# Autodesk Inventor assembly: dulap_suspendat
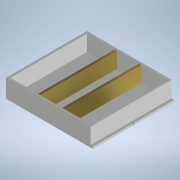
[picture p0: Inventor's stored thumbnail of the model, 180x180]
Saved by Autodesk Inventor 2022.6 (Build 266554000, 554)
## iProperties
Created: 2025-08-04
Part Number: dulap_suspendat
Document SubType Name: Assembly
Designer: Dragos Macovei
Author: Dragos Macovei
## Documents named in this file (5)
- C:\Users\Dragos Macovei\Documents\Inventor_3d_parts\Tancabesti_comanda_pal\dulap_suspendat.iam
- C:\Users\Dragos Macovei\Documents\Inventor_3d_parts\Tancabesti_comanda_pal\polita_dulap_deasupra_chiuveta.ipt
- C:\Users\Dragos Macovei\Documents\Inventor_3d_parts\Tancabesti_comanda_pal\capac-dulap_deasupra_chiuveta.ipt
- C:\Users\Dragos Macovei\Documents\Inventor_3d_parts\Tancabesti_comanda_pal\perete_lateral_dulap-suspendat.ipt
- C:\Users\Dragos Macovei\Documents\Inventor_3d_parts\Tancabesti_comanda_pal\usa dulap_suspendat_sus.ipt
## Components (8 placed, 4 different names)
1. polita_dulap_deasupra_chiuveta:2 — Mate:5, Flush:8
2. polita_dulap_deasupra_chiuveta:3 — Mate:4, Flush:7
3. capac-dulap_deasupra_chiuveta:1 — Mate:3, Flush:5, Flush:6, Flush:9, Flush:11
4. capac-dulap_deasupra_chiuveta:2 — Mate:1, Mate:2, Flush:3, Flush:4
5. perete_lateral_dulap-suspendat:1 — Flush:1, Flush:2, Mate:2, Flush:3, Mate:7, Flush:10
6. perete_lateral_dulap-suspendat:2 — Flush:1, Flush:2, Mate:1, Flush:4, Mate:3, Flush:5, Flush:6, Mate:4, Flush:7, Mate:5, Flush:8, Mate:6, Flush:12
7. usa dulap_suspendat_sus:1 — Mate:6, Flush:11, Flush:12
8. usa dulap_suspendat_sus:2 — Mate:7, Flush:9, Flush:10
## Relationships (19: Flush 12, Mate 7)
- Flush:1: perete_lateral_dulap-suspendat:1 ↔ perete_lateral_dulap-suspendat:2
- Flush:2: perete_lateral_dulap-suspendat:1 ↔ perete_lateral_dulap-suspendat:2
- Mate:1: capac-dulap_deasupra_chiuveta:2 ↔ perete_lateral_dulap-suspendat:2
- Mate:2: capac-dulap_deasupra_chiuveta:2 ↔ perete_lateral_dulap-suspendat:1
- Flush:3: capac-dulap_deasupra_chiuveta:2 ↔ perete_lateral_dulap-suspendat:1
- Flush:4: capac-dulap_deasupra_chiuveta:2 ↔ perete_lateral_dulap-suspendat:2
- Mate:3: capac-dulap_deasupra_chiuveta:1 ↔ perete_lateral_dulap-suspendat:2
- Flush:5: capac-dulap_deasupra_chiuveta:1 ↔ perete_lateral_dulap-suspendat:2
- Flush:6: capac-dulap_deasupra_chiuveta:1 ↔ perete_lateral_dulap-suspendat:2
- Mate:4: polita_dulap_deasupra_chiuveta:3 ↔ perete_lateral_dulap-suspendat:2
- Flush:7: polita_dulap_deasupra_chiuveta:3 ↔ perete_lateral_dulap-suspendat:2
- Mate:5: polita_dulap_deasupra_chiuveta:2 ↔ perete_lateral_dulap-suspendat:2
- Flush:8: polita_dulap_deasupra_chiuveta:2 ↔ perete_lateral_dulap-suspendat:2
- Mate:6: perete_lateral_dulap-suspendat:2 ↔ usa dulap_suspendat_sus:1
- Mate:7: perete_lateral_dulap-suspendat:1 ↔ usa dulap_suspendat_sus:2
- Flush:9: capac-dulap_deasupra_chiuveta:1 ↔ usa dulap_suspendat_sus:2
- Flush:10: perete_lateral_dulap-suspendat:1 ↔ usa dulap_suspendat_sus:2
- Flush:11: capac-dulap_deasupra_chiuveta:1 ↔ usa dulap_suspendat_sus:1
- Flush:12: perete_lateral_dulap-suspendat:2 ↔ usa dulap_suspendat_sus:1
